# Autodesk Inventor assembly: Kontrukcja do kamery
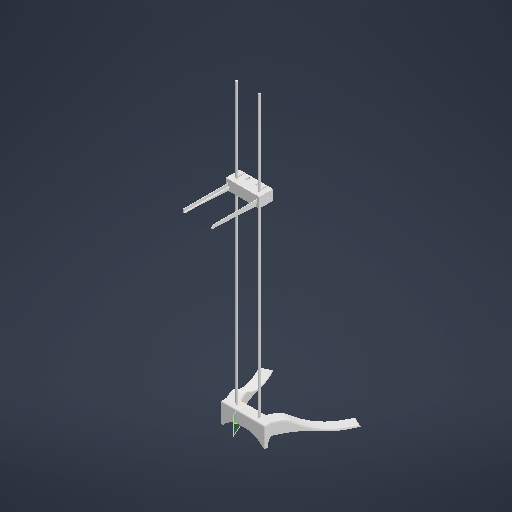
[picture p0: Inventor's stored thumbnail of the model, 512x512]
Saved by Autodesk Inventor 2026.4 (Build 304435000, 435)
## iProperties
Created: 2026-10-05
Part Number: Kontrukcja do kamery
Document SubType Name: Assembly
Designer: Matol
Author: Matol
## Documents named in this file (4)
- C:\Users\Matol\Documents\Kontrukcja do kamery.iam
- C:\Users\Matol\Documents\Podstawka do szyn.ipt
- C:\Users\Matol\Documents\Prowadnica szynowa do kamery.ipt
- C:\Users\Matol\Documents\Szyna.ipt
## Components (4 placed, 3 different names)
1. Podstawka do szyn:1 — Insert:1, Insert:2
2. Prowadnica szynowa do kamery:1 — Insert:3
3. Szyna:1 — Insert:1
4. Szyna:2 — Insert:2, Insert:3
## Relationships (3: Insert 3)
- Insert:1: Podstawka do szyn:1 ↔ Szyna:1
- Insert:2: Podstawka do szyn:1 ↔ Szyna:2
- Insert:3 (150 mm): Prowadnica szynowa do kamery:1 ↔ Szyna:2
